# Autodesk Inventor assembly: SUJETADOR_PROTO
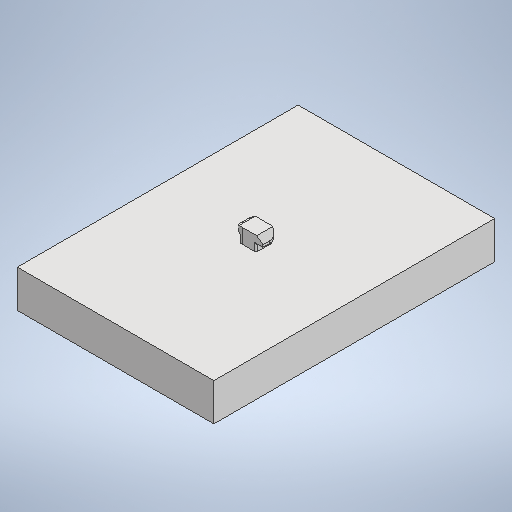
[picture p0: Inventor's stored thumbnail of the model, 512x512]
Saved by Autodesk Inventor 2025.3 (Build 293356030, 356C)
## iProperties
Created: 2026-05-06
Part Number: SUJETADOR_PROTO
Document SubType Name: Assembly
Designer: pablo
Author: pablo
## Documents named in this file (3)
- C:\Users\pablo\OneDrive - Universidad del Valle de Guatemala\Documentos\9 Semestre\Tesis\INVENTOR_TESIS\SUJETADOR_PROTO.iam
- C:\Users\pablo\OneDrive - Universidad del Valle de Guatemala\Documentos\9 Semestre\Tesis\INVENTOR_TESIS\proto.ipt
- C:\Users\pablo\OneDrive - Universidad del Valle de Guatemala\Documentos\9 Semestre\Tesis\INVENTOR_TESIS\Agarrador_20x20.ipt
## Components (2 placed, 2 different names)
1. proto:1 — Mate:1, Flush:1, Flush:2
2. Agarrador_20x20:1 — Mate:1, Flush:1, Flush:2
## Relationships (3: Flush 2, Mate 1)
- Mate:1: proto:1 ↔ Agarrador_20x20:1
- Flush:1 (42.4 mm): proto:1 ↔ Agarrador_20x20:1
- Flush:2 (28.85 mm): proto:1 ↔ Agarrador_20x20:1
